# Autodesk Inventor assembly: pl_v1
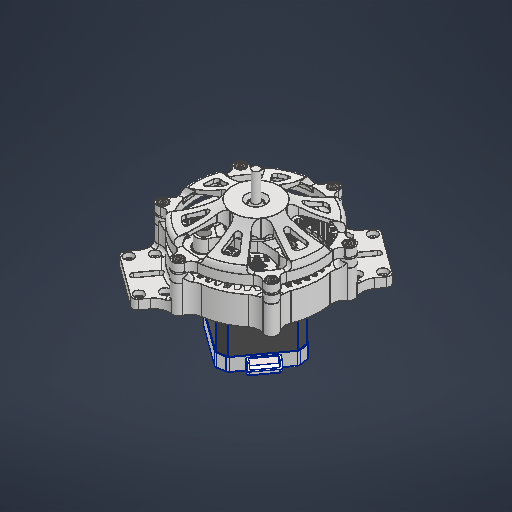
[picture p0: Inventor's stored thumbnail of the model, 512x512]
Saved by Autodesk Inventor 2026.2 (Build 302298010, 298A)
## iProperties
Created: 2026-03-26
Part Number: pl_v1
Document SubType Name: Assembly
Designer: work
Author: work
## Documents named in this file (12)
- C:\Users\work\Desktop\ARD_v1\ARD_hardware\PL121248Drive_v1\pl_v1.iam
- C:\Users\work\Desktop\ARD_v1\ARD_hardware\PL121248Drive_v1\gear_M1.5_Z16_H10.0_spur (1).ipt
- C:\Users\work\Desktop\ARD_v1\ARD_hardware\PL121248Drive_v1\gear_M1.5_Z16_H10.0_spur.ipt
- C:\Users\work\Desktop\ARD_v1\ARD_hardware\PL121248Drive_v1\gear_M1.5_Z48_H10.0_spur.ipt
- C:\Users\work\Desktop\ARD_v1\ARD_hardware\PL121248Drive_v1\KS B 1003 - M 3 x 10.ipt
- C:\Users\work\Desktop\ARD_v1\ARD_hardware\PL121248Drive_v1\NEMA17.ipt
- C:\Users\work\Desktop\ARD_v1\ARD_hardware\PL121248Drive_v1\KS B 2023 - 685 - 5 x 11 x 3 - 0.458.ipt
- C:\Users\work\Desktop\ARD_v1\ARD_hardware\PL121248Drive_v1\roter.ipt
- C:\Users\work\Desktop\ARD_v1\ARD_hardware\PL121248Drive_v1\case.ipt
- C:\Users\work\Desktop\ARD_v1\ARD_hardware\PL121248Drive_v1\KS B 1003 - M 4 x 12.ipt
- C:\Users\work\Desktop\ARD_v1\ARD_hardware\PL121248Drive_v1\KS B 2023 - 608 - 8 x 22 x 7 - 3.25.ipt
- C:\Users\work\Desktop\ARD_v1\ARD_hardware\PL121248Drive_v1\KS B 1003 - M 3 x 12.ipt
## Components (25 placed, 11 different names)
1. gear_M1.5_Z16_H10.0_spur (1):1 — 플러쉬:1, 메이트:5, 플러쉬:3, 메이트:10, 회전:2
2. gear_M1.5_Z16_H10.0_spur:1 — 플러쉬:2, 메이트:4, 메이트:11, 회전:1, 회전:2, 회전:3, 회전:4
3. gear_M1.5_Z48_H10.0_spur:1 — 메이트:1, 메이트:2, 메이트:3, 회전:1, 플러쉬:1, 플러쉬:2, 플러쉬:6, 플러쉬:7, 메이트:16, 각도:1
4. NEMA17:1 — 메이트:1, 메이트:2, 메이트:3, 메이트:4
5. gear_M1.5_Z16_H10.0_spur (1):2 — 플러쉬:7, 메이트:9, 회전:3
6. case:1 — 메이트:13, 메이트:14, 메이트:16, 메이트:17, 회전:5, 회전:6, 회전:7, 회전:8, 회전:9, 강체:1
7. roter:1 — 회전:2, 회전:3, 회전:4, 메이트:8, 메이트:9, 메이트:10, 메이트:11, 회전:4, 메이트:12, 메이트:15, 메이트:17, 각도:1
8. KS B 2023 - 685 - 5 x 11 x 3 - 0.458:1 — 메이트:5, 플러쉬:3
9. KS B 2023 - 685 - 5 x 11 x 3 - 0.458:2
10. gear_M1.5_Z16_H10.0_spur (1):3 — 플러쉬:6, 메이트:8, 회전:1, 메이트:12
11. KS B 2023 - 685 - 5 x 11 x 3 - 0.458:3
12. KS B 1003 - M 4 x 12:1 — 회전:2
13. KS B 1003 - M 4 x 12:2 — 회전:3
14. KS B 1003 - M 4 x 12:3 — 회전:4
15. KS B 2023 - 608 - 8 x 22 x 7 - 3.25:1 — 메이트:13, 메이트:14, 메이트:15
16. KS B 1003 - M 3 x 12:1 — 회전:5
17. KS B 1003 - M 3 x 12:2 — 회전:7
18. KS B 1003 - M 3 x 12:3 — 회전:9
19. KS B 1003 - M 3 x 12:4 — 회전:8
20. KS B 1003 - M 3 x 12:5 — 회전:6
21. KS B 1003 - M 3 x 12:6 — 강체:1
22. KS B 1003 - 미터 M 3 x 10:1 — 회전:1
23. KS B 1003 - 미터 M 3 x 10:2
24. KS B 1003 - 미터 M 3 x 10:3
25. KS B 1003 - 미터 M 3 x 10:4
## Component patterns: (4 elements, first: KS B 1003 - 미터 M 3 x 10:1)
## Relationships (39: Mate 17, RevoluteJoint 9, Flush 7, RelateRotation 4, WeldJoint 1, Angle 1)
- 메이트:1 [Mate]: gear_M1.5_Z48_H10.0_spur:1 ↔ NEMA17:1
- 메이트:2 [Mate]: gear_M1.5_Z48_H10.0_spur:1 ↔ NEMA17:1
- 메이트:3 [Mate]: gear_M1.5_Z48_H10.0_spur:1 ↔ NEMA17:1
- 회전:1 [RevoluteJoint]: gear_M1.5_Z48_H10.0_spur:1 ↔ KS B 1003 - 미터 M 3 x 10:1
- 플러쉬:1 [Flush]: gear_M1.5_Z16_H10.0_spur (1):1 ↔ gear_M1.5_Z48_H10.0_spur:1
- 플러쉬:2 [Flush]: gear_M1.5_Z16_H10.0_spur:1 ↔ gear_M1.5_Z48_H10.0_spur:1
- 메이트:4 [Mate]: gear_M1.5_Z16_H10.0_spur:1 ↔ NEMA17:1
- 메이트:5 [Mate]: gear_M1.5_Z16_H10.0_spur (1):1 ↔ KS B 2023 - 685 - 5 x 11 x 3 - 0.458:1
- 플러쉬:3 [Flush]: gear_M1.5_Z16_H10.0_spur (1):1 ↔ KS B 2023 - 685 - 5 x 11 x 3 - 0.458:1
- [Mate]: gear_M1.5_Z16_H10.0_spur (1):2 ↔ KS B 2023 - 685 - 5 x 11 x 3 - 0.458:2
- [Flush]: gear_M1.5_Z16_H10.0_spur (1):2 ↔ KS B 2023 - 685 - 5 x 11 x 3 - 0.458:2
- [Mate]: gear_M1.5_Z16_H10.0_spur (1):3 ↔ KS B 2023 - 685 - 5 x 11 x 3 - 0.458:3
- [Flush]: gear_M1.5_Z16_H10.0_spur (1):3 ↔ KS B 2023 - 685 - 5 x 11 x 3 - 0.458:3
- 플러쉬:6 [Flush]: gear_M1.5_Z48_H10.0_spur:1 ↔ gear_M1.5_Z16_H10.0_spur (1):3
- 플러쉬:7 [Flush]: gear_M1.5_Z48_H10.0_spur:1 ↔ gear_M1.5_Z16_H10.0_spur (1):2
- 회전:2 [RevoluteJoint]: roter:1 ↔ KS B 1003 - M 4 x 12:1
- 회전:3 [RevoluteJoint]: roter:1 ↔ KS B 1003 - M 4 x 12:2
- 회전:4 [RevoluteJoint]: roter:1 ↔ KS B 1003 - M 4 x 12:3
- 메이트:8 [Mate]: roter:1 ↔ gear_M1.5_Z16_H10.0_spur (1):3
- 메이트:9 [Mate]: gear_M1.5_Z16_H10.0_spur (1):2 ↔ roter:1
- 메이트:10 [Mate]: gear_M1.5_Z16_H10.0_spur (1):1 ↔ roter:1
- 메이트:11 [Mate]: gear_M1.5_Z16_H10.0_spur:1 ↔ roter:1
- 회전:1 [RelateRotation] (1 ul): gear_M1.5_Z16_H10.0_spur:1 ↔ gear_M1.5_Z16_H10.0_spur (1):3
- 회전:2 [RelateRotation] (1 ul): gear_M1.5_Z16_H10.0_spur (1):1 ↔ gear_M1.5_Z16_H10.0_spur:1
- 회전:3 [RelateRotation] (1 ul): gear_M1.5_Z16_H10.0_spur:1 ↔ gear_M1.5_Z16_H10.0_spur (1):2
- 회전:4 [RelateRotation] (0.25 ul): gear_M1.5_Z16_H10.0_spur:1 ↔ roter:1
- 메이트:12 [Mate]: roter:1 ↔ gear_M1.5_Z16_H10.0_spur (1):3
- 메이트:13 [Mate]: case:1 ↔ KS B 2023 - 608 - 8 x 22 x 7 - 3.25:1
- 메이트:14 [Mate]: case:1 ↔ KS B 2023 - 608 - 8 x 22 x 7 - 3.25:1
- 메이트:15 [Mate]: roter:1 ↔ KS B 2023 - 608 - 8 x 22 x 7 - 3.25:1
- 메이트:16 [Mate]: gear_M1.5_Z48_H10.0_spur:1 ↔ case:1
- 메이트:17 [Mate]: case:1 ↔ roter:1
- 회전:5 [RevoluteJoint]: case:1 ↔ KS B 1003 - M 3 x 12:1
- 회전:6 [RevoluteJoint]: case:1 ↔ KS B 1003 - M 3 x 12:5
- 회전:7 [RevoluteJoint]: case:1 ↔ KS B 1003 - M 3 x 12:2
- 회전:8 [RevoluteJoint]: case:1 ↔ KS B 1003 - M 3 x 12:4
- 회전:9 [RevoluteJoint]: case:1 ↔ KS B 1003 - M 3 x 12:3
- 강체:1 [WeldJoint]: case:1 ↔ KS B 1003 - M 3 x 12:6
- 각도:1 [Angle] (720 deg): gear_M1.5_Z48_H10.0_spur:1 ↔ roter:1
## Named parameters: d12_d10 = 0 mm, d13_d11 = 0 mm, d14_d10 = 0 mm, d15_d11 = 0 mm
